# Autodesk Inventor assembly: monotaro-rear-module
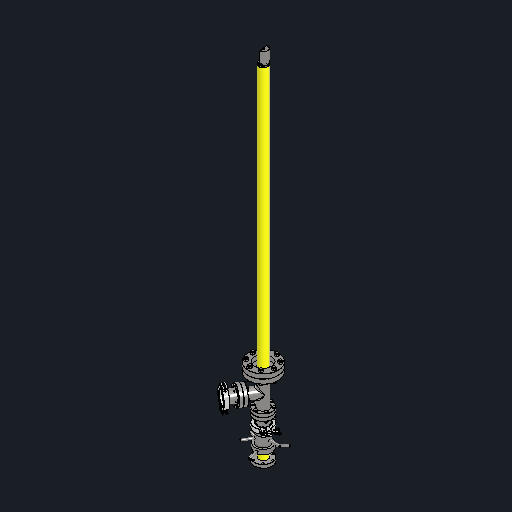
[picture p0: Inventor's stored thumbnail of the model, 512x512]
Saved by Autodesk Inventor 2027.1 (Build 311270010, 270A)
## iProperties
Created: 2026-11-14
Part Number: monotaro-rear-module
Document SubType Name: Assembly
Designer: queezz
Author: queezz
## Documents named in this file (13)
- C:\Users\queezz\Dropbox\Drawings\pihti-cad\bellows-probe\monotaro-rear-module.iam
- C:\Users\queezz\Dropbox\Drawings\pihti-cad\ContentCenter\Fastners\M6x25-HexCS.ipt
- C:\Users\queezz\Dropbox\Drawings\pihti-cad\ContentCenter\Fastners\M6x35-HexCS.ipt
- C:\Users\queezz\Dropbox\Drawings\pihti-cad\ContentCenter\Fastners\M6-nut.ipt
- C:\Users\queezz\Dropbox\Drawings\pihti-cad\ContentCenter\Fastners\m8-nut.ipt
- C:\Users\queezz\Dropbox\Drawings\pihti-cad\ContentCenter\Fastners\M8x45-HexCS.ipt
- C:\Users\queezz\Dropbox\Drawings\pihti-cad\bellows-probe\bellows_flange.ipt
- C:\Users\queezz\Dropbox\Drawings\pihti-cad\bellows-probe\CF114-CF70-zero-length-adappter.ipt
- C:\Users\queezz\Dropbox\Drawings\pihti-cad\bellows-probe\mizuno-pipe.iam
- C:\Users\queezz\Dropbox\Drawings\pihti-cad\Plasma Vessel\pipe-o-ring-gauge-port-assembly.iam
- C:\Users\queezz\Dropbox\Drawings\pihti-cad\ContentCenter\CF-parts\CF-70-Tee.ipt
- C:\Users\queezz\Dropbox\Drawings\pihti-cad\ContentCenter\CF-KF-adapters\ICF70_to_KF40.ipt
- C:\Users\queezz\Dropbox\Drawings\pihti-cad\ContentCenter\NW\NW40_clamp.ipt
## Components (53 placed, 53 different names)
1. bellows_flange:3 (carriage copy) — Probe rotation at rear flange
2. CF114-CF70-zero-length-adappter:2 (carriage copy)
3. mizuno-pipe:1 (carriage copy) [sub-assembly] — Probe rotation at rear flange
4. pipe-o-ring-gauge-port-assembly:1 (carriage copy) [sub-assembly]
5. CF-70-Tee:1 (carriage copy)
6. ICF70_to_KF40:2 (carriage copy)
7. Bypass branch KF40 clamp:1
8. M6x25 hex bolt - bypass bellows 1
9. M6x25 hex bolt - bypass bellows 2
10. M6x25 hex bolt - bypass bellows 3
11. M6x25 hex bolt - bypass bellows 4
12. M6x25 hex bolt - bypass bellows 5
13. M6x25 hex bolt - bypass bellows 6
14. M6x35 hex bolt - bypass gauge 1
15. M6 nut - bypass gauge 1
16. M6x35 hex bolt - bypass gauge 2
17. M6 nut - bypass gauge 2
18. M6x35 hex bolt - bypass gauge 3
19. M6 nut - bypass gauge 3
20. M6x35 hex bolt - bypass gauge 4
21. M6 nut - bypass gauge 4
22. M6x35 hex bolt - bypass gauge 5
23. M6 nut - bypass gauge 5
24. M6x35 hex bolt - bypass gauge 6
25. M6 nut - bypass gauge 6
26. AS 1112 (2) - Metric M8  Type 5:1 (carriage copy)
27. AS 1427 - Metric M8 x 45:1 (carriage copy)
28. AS 1427 - Metric M8 x 45:3 (carriage copy)
29. AS 1427 - Metric M8 x 45:4 (carriage copy)
30. AS 1427 - Metric M8 x 45:5 (carriage copy)
31. AS 1427 - Metric M8 x 45:6 (carriage copy)
32. AS 1427 - Metric M8 x 45:7 (carriage copy)
33. AS 1427 - Metric M8 x 45:8 (carriage copy)
34. AS 1427 - Metric M8 x 45:9 (carriage copy)
35. AS 1112 (2) - Metric M8  Type 5:3 (carriage copy)
36. AS 1112 (2) - Metric M8  Type 5:4 (carriage copy)
37. AS 1112 (2) - Metric M8  Type 5:5 (carriage copy)
38. AS 1112 (2) - Metric M8  Type 5:6 (carriage copy)
39. AS 1112 (2) - Metric M8  Type 5:7 (carriage copy)
40. AS 1112 (2) - Metric M8  Type 5:8 (carriage copy)
41. AS 1112 (2) - Metric M8  Type 5:9 (carriage copy)
42. M6x35 hex bolt - bypass branch 1
43. M6 nut - bypass branch 1
44. M6x35 hex bolt - bypass branch 2
45. M6 nut - bypass branch 2
46. M6x35 hex bolt - bypass branch 3
47. M6 nut - bypass branch 3
48. M6x35 hex bolt - bypass branch 4
49. M6 nut - bypass branch 4
50. M6x35 hex bolt - bypass branch 5
51. M6 nut - bypass branch 5
52. M6x35 hex bolt - bypass branch 6
53. M6 nut - bypass branch 6
## Relationships (1: Insert 1)
- Probe rotation at rear flange [Insert] (-325 mm): bellows_flange:3 (carriage copy) ↔ mizuno-pipe:1 (carriage copy)
